# Autodesk Inventor assembly: 4444 FP-1246x1546x47
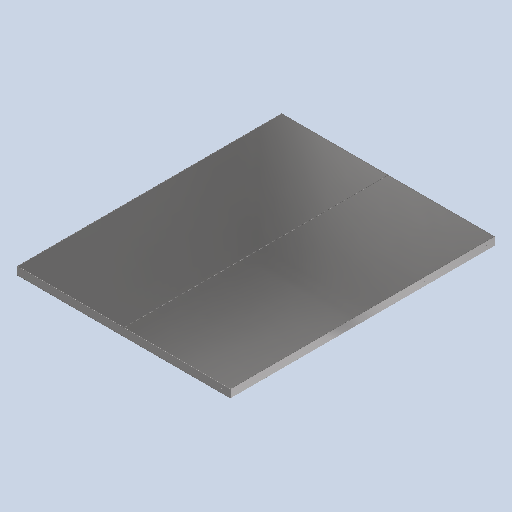
[picture p0: Inventor's stored thumbnail of the model, 512x512]
Saved by Autodesk Inventor 2024.4 (Build 284460030, 460C)
## iProperties
RuleStatus: InUse
Created: 2019-06-24
Part Number: 4444 FP-1246x1546x47
Material: Generisch
Document SubType Name: Assembly
Designer: MK
Mass: 27437.8 g
Surface Area: 70062.5 cm^2
Volume: 3495.27 cm^3
Density: 7.85 g/cm^3
Description: Tür-Paneel
InventorSizerSetup: FP 2
Author: MK
## Documents named in this file (3)
- C:\Users\ahmad\OneDrive\Desktop\Inventor_Sizer\C# Version\GR\Einzelteile\4444 FP-1246x1546x47.iam
- C:\Users\ahmad\OneDrive\Desktop\Inventor_Sizer\C# Version\GR\Einzelteile\4444 1246x1546x47-Au.ipt
- C:\Users\ahmad\OneDrive\Desktop\Inventor_Sizer\C# Version\GR\Einzelteile\4444 1246x1546x47-In-2T.ipt
## Components (3 placed, 2 different names)
1. 4444 1246x1546x47-Au:1 — Mate:6, Mate:7, Mate:8
2. 4444 1246x1546x47-In-2T:1 — Mate:6, Mate:7, Mate:8
3. 4444 1246x1546x47-In-2T:2
## Component patterns: (2 elements, first: 4444 1246x1546x47-In-2T:1)
## Relationships (3: Mate 3)
- Mate:6: 4444 1246x1546x47-Au:1 ↔ 4444 1246x1546x47-In-2T:1
- Mate:7 (0.5 mm): 4444 1246x1546x47-Au:1 ↔ 4444 1246x1546x47-In-2T:1
- Mate:8 (0.5 mm): 4444 1246x1546x47-Au:1 ↔ 4444 1246x1546x47-In-2T:1
## Named parameters: Clearance = 0.5 mm, Width = 1246 mm, InSplit = 2, InWidth = 621.5 mm
